# Autodesk Inventor assembly: Cantoneira montada perfil x perfil
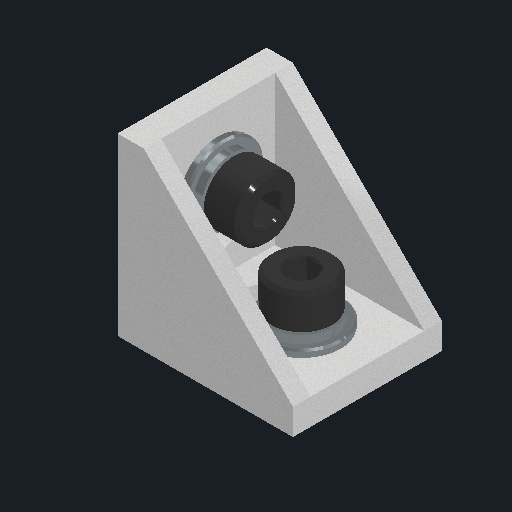
[picture p0: Inventor's stored thumbnail of the model, 512x512]
Saved by Autodesk Inventor 2026.1 (Build 301233000, 233)
## iProperties
Created: 2025-07-09
Part Number: Cantoneira montada perfil x perfil
Document SubType Name: Assembly
Designer: Cliente
Mass: 12.5896 g
Surface Area: 37.0221 cm^2
Volume: 3.05563 cm^3
Density: 4.12014 g/cm^3
Author: Cliente
## Documents named in this file (6)
- C:\Users\Cliente\Desktop\TCC\Fixação\Cantoneira montada perfil x perfil.iam
- C:\Users\Cliente\Desktop\TCC\Fixação\Cantoneira em alumínio 20X20X17.ipt
- C:\Users\Cliente\Desktop\TCC\Fixação\Arruela Lisa DIN 125 - B4 - 300 HV.ipt
- C:\Users\Cliente\Desktop\TCC\Fixação\Arruela de Pressão DIN 127 - B4.ipt
- C:\Users\Cliente\Desktop\TCC\Fixação\Parafuso Allen Cabeça Cilíndrica DIN 912 - M4 - 12.9.ipt
- C:\Users\Cliente\Desktop\TCC\Fixação\Porca martelo M4 canal 6.ipt
## Components (9 placed, 5 different names)
1. Cantoneira em alumínio 20X20X17:1 — Alinhado:1, Alinhado:2, Alinhado:3, Coincidente:1, Coincidente:2, Tangente:1, Tangente:2, Ângulo:1, Ângulo:2, Coincidente:14, Coincidente:15
2. Arruela Lisa DIN 125 - B4 - 300 HV:1 — Coincidente:2, Alinhado:4, Coincidente:3, Coincidente:6, Coincidente:9
3. Arruela Lisa DIN 125 - B4 - 300 HV:2 — Coincidente:1, Alinhado:5, Coincidente:4, Coincidente:5, Coincidente:11
4. Arruela de Pressão DIN 127 - B4:1 — Coincidente:3, Coincidente:6, Alinhado:6, Coincidente:8
5. Arruela de Pressão DIN 127 - B4:2 — Coincidente:4, Coincidente:5, Coincidente:7, Coincidente:10
6. Parafuso Allen Cabeça Cilíndrica DIN 912 - M4 - 12.9:1 — Coincidente:8, Coincidente:9, Tangente:1, Alinhado:7, Coincidente:12
7. Parafuso Allen Cabeça Cilíndrica DIN 912 - M4 - 12.9:2 — Alinhado:8, Coincidente:10, Coincidente:11, Tangente:2, Coincidente:13
8. Porca martelo M4 canal 6:1 — Coincidente:12, Ângulo:1, Coincidente:15
9. Porca martelo M4 canal 6:2 — Coincidente:13, Ângulo:2, Coincidente:14
## Relationships (27: Mate 15, Flush 8, Tangent 2, Angle 2)
- Alinhado:1 [Flush]: Cantoneira em alumínio 20X20X17:1
- Alinhado:2 [Flush]: Cantoneira em alumínio 20X20X17:1
- Alinhado:3 [Flush]: Cantoneira em alumínio 20X20X17:1
- Coincidente:1 [Mate]: Cantoneira em alumínio 20X20X17:1 ↔ Arruela Lisa DIN 125 - B4 - 300 HV:2
- Coincidente:2 [Mate]: Cantoneira em alumínio 20X20X17:1 ↔ Arruela Lisa DIN 125 - B4 - 300 HV:1
- Alinhado:4 [Flush]: Arruela Lisa DIN 125 - B4 - 300 HV:1
- Alinhado:5 [Flush]: Arruela Lisa DIN 125 - B4 - 300 HV:2
- Coincidente:3 [Mate]: Arruela Lisa DIN 125 - B4 - 300 HV:1 ↔ Arruela de Pressão DIN 127 - B4:1
- Coincidente:4 [Mate]: Arruela Lisa DIN 125 - B4 - 300 HV:2 ↔ Arruela de Pressão DIN 127 - B4:2
- Coincidente:5 [Mate]: Arruela Lisa DIN 125 - B4 - 300 HV:2 ↔ Arruela de Pressão DIN 127 - B4:2
- Coincidente:6 [Mate]: Arruela Lisa DIN 125 - B4 - 300 HV:1 ↔ Arruela de Pressão DIN 127 - B4:1
- Alinhado:6 [Flush]: Arruela de Pressão DIN 127 - B4:1
- Coincidente:7 [Mate]: Arruela de Pressão DIN 127 - B4:2
- Coincidente:8 [Mate]: Arruela de Pressão DIN 127 - B4:1 ↔ Parafuso Allen Cabeça Cilíndrica DIN 912 - M4 - 12.9:1
- Coincidente:9 [Mate]: Arruela Lisa DIN 125 - B4 - 300 HV:1 ↔ Parafuso Allen Cabeça Cilíndrica DIN 912 - M4 - 12.9:1
- Tangente:1: Cantoneira em alumínio 20X20X17:1 ↔ Parafuso Allen Cabeça Cilíndrica DIN 912 - M4 - 12.9:1
- Alinhado:7 [Flush]: Parafuso Allen Cabeça Cilíndrica DIN 912 - M4 - 12.9:1
- Alinhado:8 [Flush]: Parafuso Allen Cabeça Cilíndrica DIN 912 - M4 - 12.9:2
- Coincidente:10 [Mate]: Arruela de Pressão DIN 127 - B4:2 ↔ Parafuso Allen Cabeça Cilíndrica DIN 912 - M4 - 12.9:2
- Coincidente:11 [Mate]: Arruela Lisa DIN 125 - B4 - 300 HV:2 ↔ Parafuso Allen Cabeça Cilíndrica DIN 912 - M4 - 12.9:2
- Tangente:2: Cantoneira em alumínio 20X20X17:1 ↔ Parafuso Allen Cabeça Cilíndrica DIN 912 - M4 - 12.9:2
- Coincidente:12 [Mate]: Parafuso Allen Cabeça Cilíndrica DIN 912 - M4 - 12.9:1 ↔ Porca martelo M4 canal 6:1
- Coincidente:13 [Mate]: Parafuso Allen Cabeça Cilíndrica DIN 912 - M4 - 12.9:2 ↔ Porca martelo M4 canal 6:2
- Ângulo:1 [Angle] (0 deg): Cantoneira em alumínio 20X20X17:1 ↔ Porca martelo M4 canal 6:1
- Ângulo:2 [Angle] (0 deg): Cantoneira em alumínio 20X20X17:1 ↔ Porca martelo M4 canal 6:2
- Coincidente:14 [Mate] (1.8 mm): Cantoneira em alumínio 20X20X17:1 ↔ Porca martelo M4 canal 6:2
- Coincidente:15 [Mate] (1.8 mm): Cantoneira em alumínio 20X20X17:1 ↔ Porca martelo M4 canal 6:1
